# Autodesk Inventor assembly: PneumaticGripper_v1
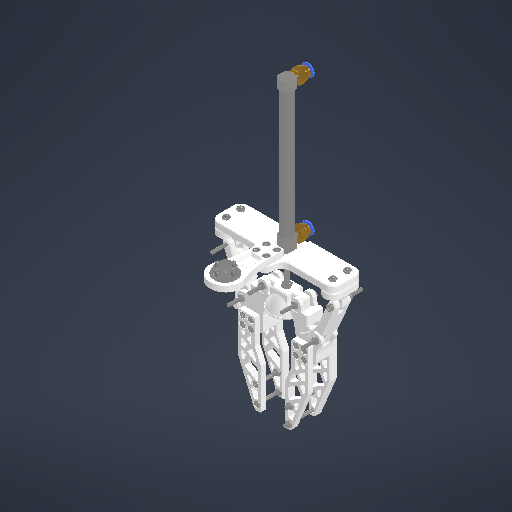
[picture p0: Inventor's stored thumbnail of the model, 512x512]
Saved by Autodesk Inventor 2026.2 (Build 302298010, 298A)
## iProperties
Created: 2026-05-08
Part Number: PneumaticGripper_v1
Document SubType Name: Assembly
Designer: work
Author: work
## Documents named in this file (16)
- C:\Users\work\Desktop\ARD_v1\ARD_hardware\PneumaticGripper_v1\PneumaticGripper_v1.iam
- C:\Users\work\Desktop\ARD_v1\ARD_hardware\PneumaticGripper_v1\Pneumatic fitting\CDJ2B10_100\CDJ2B10.iam
- C:\Users\work\Desktop\ARD_v1\ARD_hardware\PneumaticGripper_v1\Cylinder fixing parts.ipt
- C:\Users\work\Desktop\ARD_v1\ARD_hardware\PneumaticGripper_v1\rod-fixing parts.ipt
- C:\Users\work\Desktop\ARD_v1\ARD_hardware\PneumaticGripper_v1\Pneumatic fitting\CDJ2B10_100\Rod.ipt
- C:\Users\work\Desktop\ARD_v1\ARD_hardware\PneumaticGripper_v1\Pneumatic fitting\CDJ2B10_100\AS 1474 - M4(1).ipt
- C:\Users\work\Desktop\ARD_v1\ARD_hardware\PneumaticGripper_v1\Bottom Link Parts.ipt
- C:\Users\work\Desktop\ARD_v1\ARD_hardware\PneumaticGripper_v1\Link Support Parts.ipt
- C:\Users\work\Desktop\ARD_v1\ARD_hardware\PneumaticGripper_v1\Link Parts.ipt
- C:\Users\work\Desktop\ARD_v1\ARD_hardware\PneumaticGripper_v1\Tongs_R.ipt
- C:\Users\work\Desktop\ARD_v1\ARD_hardware\PneumaticGripper_v1\Tongs_l.ipt
- C:\Users\work\Desktop\ARD_v1\ARD_hardware\SCARA_v1\Object\KS B 1003 - M 3 x 12.ipt
- C:\Users\work\Desktop\ARD_v1\ARD_hardware\PneumaticGripper_v1\Object\KS B 1003 - M 3 x 30.ipt
- C:\Users\work\Desktop\ARD_v1\ARD_hardware\PneumaticGripper_v1\Object\JIS B 1181 - A_B M3.ipt
- C:\Users\work\Desktop\ARD_v1\ARD_hardware\PneumaticGripper_v1\Flange Bracket.ipt
- C:\Users\work\Desktop\ARD_v1\ARD_hardware\PneumaticGripper_v1\Object\flange joint 16pi (5 to 3).ipt
## Components (81 placed, 15 different names)
1. CDJ2B10:1 [sub-assembly] — 메이트:1, 각도:1, 메이트:2, 메이트:8
2. Cylinder fixing parts:1 — 메이트:1, 각도:1, 메이트:2, 메이트:9, 각도:4, 메이트:15, 메이트:16, 메이트:17, 메이트:18, 메이트:19, 메이트:20, 삽입:37, 삽입:38, 삽입:40, 삽입:41, 메이트:42, 메이트:43, 메이트:44, 플러쉬:2, 메이트:45, 메이트:46, 삽입:58, 삽입:59, 삽입:60, 삽입:61
3. rod-fixing parts:1 — 메이트:3, 메이트:6, 메이트:7, 각도:2, 각도:3, 각도:4, 메이트:10, 메이트:12, 메이트:13, 메이트:14, 각도:5, 각도:6
4. Rod:1 — 메이트:3, 메이트:4, 메이트:5, 플러쉬:1, 메이트:8, 메이트:9
5. Flange Bracket:1 — 메이트:39, 메이트:40, 메이트:41, 메이트:42, 메이트:43, 메이트:44, 삽입:49, 삽입:50, 삽입:51, 삽입:52, 삽입:53, 삽입:54, 삽입:55, 삽입:56
6. AS 1474 - M4(1):1 — 메이트:5, 메이트:6, 각도:2, 플러쉬:1
7. AS 1474 - M4(1):2 — 메이트:4, 메이트:7, 각도:3
8. Bottom Link Parts:1 — 메이트:12, 메이트:14, 회전:1, 각도:5, 메이트:26, 메이트:33, 메이트:34, 메이트:35, 메이트:36, 메이트:37, 메이트:38, 삽입:21, 삽입:23, 삽입:33, 삽입:34, 각도:7
9. Bottom Link Parts:2 — 메이트:10, 메이트:13, 회전:1, 각도:6, 메이트:22, 메이트:27, 메이트:28, 메이트:29, 메이트:30, 메이트:31, 메이트:32, 삽입:22, 삽입:24, 삽입:31, 삽입:48, 각도:7
10. Link Support Parts:1 — 메이트:15, 메이트:16, 메이트:17, 메이트:21, 메이트:23, 삽입:19, 삽입:20
11. Link Support Parts:2 — 메이트:18, 메이트:19, 메이트:20, 메이트:24, 메이트:25, 삽입:17, 삽입:18
12. Link Parts:1 — 메이트:21, 메이트:22, 메이트:23, 삽입:29
13. Link Parts:3 — 메이트:24, 메이트:25, 메이트:26, 삽입:30, 삽입:39
14. Tongs_R:1 — 메이트:27, 메이트:28, 메이트:29, 삽입:5, 삽입:6, 삽입:7, 삽입:8, 삽입:42, 삽입:43, 삽입:44, 삽입:45
15. Tongs_l:1 — 메이트:30, 메이트:31, 메이트:32, 삽입:9, 삽입:10, 삽입:11, 삽입:12, 삽입:27, 삽입:28, 접선:1
16. Tongs_R:3 — 메이트:33, 메이트:34, 메이트:35, 삽입:13, 삽입:14, 삽입:15, 삽입:16, 삽입:35, 삽입:36, 삽입:46, 삽입:47, 접선:1
17. Tongs_l:2 — 메이트:36, 메이트:37, 메이트:38, 삽입:1, 삽입:2, 삽입:3, 삽입:4, 삽입:25, 삽입:26
18. JIS B 1181 - A_B M3:18 — 삽입:58
19. JIS B 1181 - A_B M3:19 — 삽입:59
20. JIS B 1181 - A_B M3:20 — 삽입:60
21. JIS B 1181 - A_B M3:21 — 삽입:61
22. JIS B 1181 - A_B M3:22 — 삽입:62
23. JIS B 1181 - A_B M3:23 — 삽입:63
24. JIS B 1181 - A_B M3:24 — 삽입:64
25. JIS B 1181 - A_B M3:25 — 삽입:65
26. KS B 1003 - M 3 x 12:22 — 삽입:49
27. KS B 1003 - M 3 x 12:23 — 삽입:50
28. KS B 1003 - M 3 x 12:24 — 삽입:51
29. KS B 1003 - M 3 x 12:25 — 삽입:52
30. KS B 1003 - M 3 x 12:26 — 삽입:53
31. KS B 1003 - M 3 x 12:27 — 삽입:54
32. KS B 1003 - M 3 x 12:28 — 삽입:55
33. KS B 1003 - M 3 x 12:29 — 삽입:56
34. KS B 1003 - M 3 x 12:1 — 삽입:9
35. KS B 1003 - M 3 x 12:2 — 삽입:1
36. KS B 1003 - M 3 x 12:3 — 삽입:2
37. KS B 1003 - M 3 x 12:4 — 삽입:3
38. KS B 1003 - M 3 x 12:5 — 삽입:4
39. KS B 1003 - M 3 x 12:6 — 삽입:5
40. KS B 1003 - M 3 x 12:7 — 삽입:6
41. KS B 1003 - M 3 x 12:8 — 삽입:7
42. KS B 1003 - M 3 x 12:9 — 삽입:8
43. KS B 1003 - M 3 x 12:11 — 삽입:10
44. KS B 1003 - M 3 x 12:12 — 삽입:11
45. KS B 1003 - M 3 x 12:13 — 삽입:12
46. KS B 1003 - M 3 x 12:14 — 삽입:13
47. KS B 1003 - M 3 x 12:15 — 삽입:14
48. KS B 1003 - M 3 x 12:16 — 삽입:15
49. KS B 1003 - M 3 x 12:17 — 삽입:16
50. KS B 1003 - M 3 x 12:18 — 삽입:17
51. KS B 1003 - M 3 x 12:19 — 삽입:18
52. KS B 1003 - M 3 x 12:20 — 삽입:19
53. KS B 1003 - M 3 x 12:21 — 삽입:20
54. KS B 1003 - M 3 x 30:1 — 삽입:21
55. KS B 1003 - M 3 x 30:2 — 삽입:22
56. KS B 1003 - M 3 x 30:3 — 삽입:23
57. flange joint 16pi (5 to 3):1 — 메이트:39, 메이트:40, 메이트:41, 삽입:62, 삽입:63, 삽입:64, 삽입:65
58. KS B 1003 - M 3 x 30:4 — 삽입:24
59. KS B 1003 - M 3 x 30:5 — 삽입:25
60. KS B 1003 - M 3 x 30:6 — 삽입:26
61. KS B 1003 - M 3 x 30:7 — 삽입:27
62. KS B 1003 - M 3 x 30:8 — 삽입:28
63. KS B 1003 - M 3 x 30:9 — 삽입:29
64. KS B 1003 - M 3 x 30:10 — 삽입:30
65. JIS B 1181 - A_B M3:1 — 삽입:31
66. JIS B 1181 - A_B M3:2 — 삽입:33
67. JIS B 1181 - A_B M3:3 — 삽입:34
68. JIS B 1181 - A_B M3:4 — 삽입:35
69. JIS B 1181 - A_B M3:5 — 삽입:36
70. JIS B 1181 - A_B M3:6 — 삽입:37
71. JIS B 1181 - A_B M3:7 — 삽입:38
72. JIS B 1181 - A_B M3:8 — 삽입:39
73. JIS B 1181 - A_B M3:9 — 삽입:40
74. JIS B 1181 - A_B M3:10 — 삽입:41
75. JIS B 1181 - A_B M3:11 — 삽입:42
76. JIS B 1181 - A_B M3:12 — 삽입:43
77. JIS B 1181 - A_B M3:13 — 삽입:44
78. JIS B 1181 - A_B M3:14 — 삽입:45
79. JIS B 1181 - A_B M3:15 — 삽입:46
80. JIS B 1181 - A_B M3:16 — 삽입:47
81. JIS B 1181 - A_B M3:17 — 삽입:48
## Relationships (119: Insert 63, Mate 45, Angle 7, Flush 2, RelateRotation 1, Tangent 1)
- 메이트:1 [Mate]: CDJ2B10:1 ↔ Cylinder fixing parts:1
- 각도:1 [Angle] (0 deg): CDJ2B10:1 ↔ Cylinder fixing parts:1
- 메이트:2 [Mate]: CDJ2B10:1 ↔ Cylinder fixing parts:1
- 메이트:3 [Mate]: rod-fixing parts:1 ↔ Rod:1
- 메이트:4 [Mate]: Rod:1 ↔ AS 1474 - M4(1):2
- 메이트:5 [Mate]: Rod:1 ↔ AS 1474 - M4(1):1
- 메이트:6 [Mate]: rod-fixing parts:1 ↔ AS 1474 - M4(1):1
- 메이트:7 [Mate]: rod-fixing parts:1 ↔ AS 1474 - M4(1):2
- 각도:2 [Angle] (0 deg): rod-fixing parts:1 ↔ AS 1474 - M4(1):1
- 각도:3 [Angle] (0 deg): rod-fixing parts:1 ↔ AS 1474 - M4(1):2
- 플러쉬:1 [Flush] (5 mm): Rod:1 ↔ AS 1474 - M4(1):1
- 메이트:8 [Mate]: CDJ2B10:1 ↔ Rod:1
- 메이트:9 [Mate]: Cylinder fixing parts:1 ↔ Rod:1
- 각도:4 [Angle] (0 deg): Cylinder fixing parts:1 ↔ rod-fixing parts:1
- 메이트:10 [Mate]: rod-fixing parts:1 ↔ Bottom Link Parts:2
- 메이트:12 [Mate]: rod-fixing parts:1 ↔ Bottom Link Parts:1
- 메이트:13 [Mate]: rod-fixing parts:1 ↔ Bottom Link Parts:2
- 메이트:14 [Mate]: rod-fixing parts:1 ↔ Bottom Link Parts:1
- 회전:1 [RelateRotation] (1 ul): Bottom Link Parts:1 ↔ Bottom Link Parts:2
- 각도:5 [Angle] (0 deg): rod-fixing parts:1 ↔ Bottom Link Parts:1
- 각도:6 [Angle] (0 deg): rod-fixing parts:1 ↔ Bottom Link Parts:2
- 메이트:15 [Mate]: Cylinder fixing parts:1 ↔ Link Support Parts:1
- 메이트:16 [Mate]: Cylinder fixing parts:1 ↔ Link Support Parts:1
- 메이트:17 [Mate]: Cylinder fixing parts:1 ↔ Link Support Parts:1
- 메이트:18 [Mate]: Cylinder fixing parts:1 ↔ Link Support Parts:2
- 메이트:19 [Mate]: Cylinder fixing parts:1 ↔ Link Support Parts:2
- 메이트:20 [Mate]: Cylinder fixing parts:1 ↔ Link Support Parts:2
- 메이트:21 [Mate]: Link Support Parts:1 ↔ Link Parts:1
- 메이트:22 [Mate]: Bottom Link Parts:2 ↔ Link Parts:1
- 메이트:23 [Mate]: Link Support Parts:1 ↔ Link Parts:1
- 메이트:24 [Mate]: Link Support Parts:2 ↔ Link Parts:3
- 메이트:25 [Mate]: Link Support Parts:2 ↔ Link Parts:3
- 메이트:26 [Mate]: Bottom Link Parts:1 ↔ Link Parts:3
- 메이트:27 [Mate]: Bottom Link Parts:2 ↔ Tongs_R:1
- 메이트:28 [Mate]: Bottom Link Parts:2 ↔ Tongs_R:1
- 메이트:29 [Mate]: Bottom Link Parts:2 ↔ Tongs_R:1
- 메이트:30 [Mate]: Bottom Link Parts:2 ↔ Tongs_l:1
- 메이트:31 [Mate]: Bottom Link Parts:2 ↔ Tongs_l:1
- 메이트:32 [Mate]: Bottom Link Parts:2 ↔ Tongs_l:1
- 메이트:33 [Mate]: Bottom Link Parts:1 ↔ Tongs_R:3
- 메이트:34 [Mate]: Bottom Link Parts:1 ↔ Tongs_R:3
- 메이트:35 [Mate]: Bottom Link Parts:1 ↔ Tongs_R:3
- 메이트:36 [Mate]: Bottom Link Parts:1 ↔ Tongs_l:2
- 메이트:37 [Mate]: Bottom Link Parts:1 ↔ Tongs_l:2
- 메이트:38 [Mate]: Bottom Link Parts:1 ↔ Tongs_l:2
- 삽입:1 [Insert]: Tongs_l:2 ↔ KS B 1003 - M 3 x 12:2
- 삽입:2 [Insert]: Tongs_l:2 ↔ KS B 1003 - M 3 x 12:3
- 삽입:3 [Insert]: Tongs_l:2 ↔ KS B 1003 - M 3 x 12:4
- 삽입:4 [Insert]: Tongs_l:2 ↔ KS B 1003 - M 3 x 12:5
- 삽입:5 [Insert]: Tongs_R:1 ↔ KS B 1003 - M 3 x 12:6
- 삽입:6 [Insert]: Tongs_R:1 ↔ KS B 1003 - M 3 x 12:7
- 삽입:7 [Insert]: Tongs_R:1 ↔ KS B 1003 - M 3 x 12:8
- 삽입:8 [Insert]: Tongs_R:1 ↔ KS B 1003 - M 3 x 12:9
- 삽입:9 [Insert]: Tongs_l:1 ↔ KS B 1003 - M 3 x 12:1
- 삽입:10 [Insert]: Tongs_l:1 ↔ KS B 1003 - M 3 x 12:11
- 삽입:11 [Insert]: Tongs_l:1 ↔ KS B 1003 - M 3 x 12:12
- 삽입:12 [Insert]: Tongs_l:1 ↔ KS B 1003 - M 3 x 12:13
- 삽입:13 [Insert]: Tongs_R:3 ↔ KS B 1003 - M 3 x 12:14
- 삽입:14 [Insert]: Tongs_R:3 ↔ KS B 1003 - M 3 x 12:15
- 삽입:15 [Insert]: Tongs_R:3 ↔ KS B 1003 - M 3 x 12:16
- 삽입:16 [Insert]: Tongs_R:3 ↔ KS B 1003 - M 3 x 12:17
- 삽입:17 [Insert]: Link Support Parts:2 ↔ KS B 1003 - M 3 x 12:18
- 삽입:18 [Insert]: Link Support Parts:2 ↔ KS B 1003 - M 3 x 12:19
- 삽입:19 [Insert]: Link Support Parts:1 ↔ KS B 1003 - M 3 x 12:20
- 삽입:20 [Insert]: Link Support Parts:1 ↔ KS B 1003 - M 3 x 12:21
- 삽입:21 [Insert]: Bottom Link Parts:1 ↔ KS B 1003 - M 3 x 30:1
- 삽입:22 [Insert]: Bottom Link Parts:2 ↔ KS B 1003 - M 3 x 30:2
- 삽입:23 [Insert]: Bottom Link Parts:1 ↔ KS B 1003 - M 3 x 30:3
- 삽입:24 [Insert]: Bottom Link Parts:2 ↔ KS B 1003 - M 3 x 30:4
- 삽입:25 [Insert]: Tongs_l:2 ↔ KS B 1003 - M 3 x 30:5
- 삽입:26 [Insert]: Tongs_l:2 ↔ KS B 1003 - M 3 x 30:6
- 삽입:27 [Insert]: Tongs_l:1 ↔ KS B 1003 - M 3 x 30:7
- 삽입:28 [Insert]: Tongs_l:1 ↔ KS B 1003 - M 3 x 30:8
- 삽입:29 [Insert]: Link Parts:1 ↔ KS B 1003 - M 3 x 30:9
- 삽입:30 [Insert]: Link Parts:3 ↔ KS B 1003 - M 3 x 30:10
- 삽입:31 [Insert]: Bottom Link Parts:2 ↔ JIS B 1181 - A_B M3:1
- 삽입:33 [Insert]: Bottom Link Parts:1 ↔ JIS B 1181 - A_B M3:2
- 삽입:34 [Insert]: Bottom Link Parts:1 ↔ JIS B 1181 - A_B M3:3
- 삽입:35 [Insert]: Tongs_R:3 ↔ JIS B 1181 - A_B M3:4
- 삽입:36 [Insert]: Tongs_R:3 ↔ JIS B 1181 - A_B M3:5
- 삽입:37 [Insert]: Cylinder fixing parts:1 ↔ JIS B 1181 - A_B M3:6
- 삽입:38 [Insert]: Cylinder fixing parts:1 ↔ JIS B 1181 - A_B M3:7
- 삽입:39 [Insert]: Link Parts:3 ↔ JIS B 1181 - A_B M3:8
- 삽입:40 [Insert]: Cylinder fixing parts:1 ↔ JIS B 1181 - A_B M3:9
- 삽입:41 [Insert]: Cylinder fixing parts:1 ↔ JIS B 1181 - A_B M3:10
- 삽입:42 [Insert]: Tongs_R:1 ↔ JIS B 1181 - A_B M3:11
- 삽입:43 [Insert]: Tongs_R:1 ↔ JIS B 1181 - A_B M3:12
- 삽입:44 [Insert]: Tongs_R:1 ↔ JIS B 1181 - A_B M3:13
- 삽입:45 [Insert]: Tongs_R:1 ↔ JIS B 1181 - A_B M3:14
- 삽입:46 [Insert]: Tongs_R:3 ↔ JIS B 1181 - A_B M3:15
- 삽입:47 [Insert]: Tongs_R:3 ↔ JIS B 1181 - A_B M3:16
- 삽입:48 [Insert]: Bottom Link Parts:2 ↔ JIS B 1181 - A_B M3:17
- 접선:1 [Tangent] (10 mm): Tongs_l:1 ↔ Tongs_R:3
- 메이트:39 [Mate]: Flange Bracket:1 ↔ flange joint 16pi (5 to 3):1
- 메이트:40 [Mate]: Flange Bracket:1 ↔ flange joint 16pi (5 to 3):1
- 메이트:41 [Mate]: Flange Bracket:1 ↔ flange joint 16pi (5 to 3):1
- 메이트:42 [Mate]: Cylinder fixing parts:1 ↔ Flange Bracket:1
- 메이트:43 [Mate]: Cylinder fixing parts:1 ↔ Flange Bracket:1
- 메이트:44 [Mate]: Cylinder fixing parts:1 ↔ Flange Bracket:1
- 삽입:49 [Insert]: Flange Bracket:1 ↔ KS B 1003 - M 3 x 12:22
- 삽입:50 [Insert]: Flange Bracket:1 ↔ KS B 1003 - M 3 x 12:23
- 삽입:51 [Insert]: Flange Bracket:1 ↔ KS B 1003 - M 3 x 12:24
- 삽입:52 [Insert]: Flange Bracket:1 ↔ KS B 1003 - M 3 x 12:25
- 삽입:53 [Insert]: Flange Bracket:1 ↔ KS B 1003 - M 3 x 12:26
- 삽입:54 [Insert]: Flange Bracket:1 ↔ KS B 1003 - M 3 x 12:27
- 삽입:55 [Insert]: Flange Bracket:1 ↔ KS B 1003 - M 3 x 12:28
- 삽입:56 [Insert]: Flange Bracket:1 ↔ KS B 1003 - M 3 x 12:29
- 플러쉬:2 [Flush] (-150 mm): Cylinder fixing parts:1
- 메이트:45 [Mate]: Cylinder fixing parts:1
- 메이트:46 [Mate]: Cylinder fixing parts:1
- 삽입:58 [Insert]: Cylinder fixing parts:1 ↔ JIS B 1181 - A_B M3:18
- 삽입:59 [Insert]: Cylinder fixing parts:1 ↔ JIS B 1181 - A_B M3:19
- 삽입:60 [Insert]: Cylinder fixing parts:1 ↔ JIS B 1181 - A_B M3:20
- 삽입:61 [Insert]: Cylinder fixing parts:1 ↔ JIS B 1181 - A_B M3:21
- 삽입:62 [Insert]: JIS B 1181 - A_B M3:22 ↔ flange joint 16pi (5 to 3):1
- 삽입:63 [Insert]: JIS B 1181 - A_B M3:23 ↔ flange joint 16pi (5 to 3):1
- 삽입:64 [Insert]: JIS B 1181 - A_B M3:24 ↔ flange joint 16pi (5 to 3):1
- 삽입:65 [Insert]: JIS B 1181 - A_B M3:25 ↔ flange joint 16pi (5 to 3):1
- 각도:7 [Angle] (0 deg): Bottom Link Parts:1 ↔ Bottom Link Parts:2
